# Autodesk Inventor assembly: Cadena
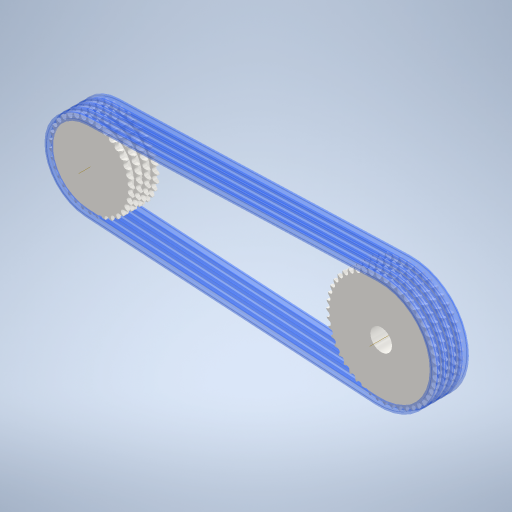
[picture p0: Inventor's stored thumbnail of the model, 512x512]
Saved by Autodesk Inventor 2024 (Build 280153000, 153)
## iProperties
Created: 2024-09-19
Part Number: Cadena
Document SubType Name: Assembly
Designer: aulac205
Author: aulac205
## Documents named in this file (2)
- C:\Users\aulac205\Documents\Inventor\Cadena.iam
- C:\Users\aulac205\Documents\Inventor\Cadena\Design Accelerator\Transmisión por cadena1.iam
## Components (1 placed, 1 different names)
1. Transmisión por cadena:1 [sub-assembly] — Coincidencia:1
## Relationships (1: Mate 1)
- Coincidencia:1 [Mate]: Transmisión por cadena:1
